# Autodesk Inventor assembly: Zespol_plyty_przedniej
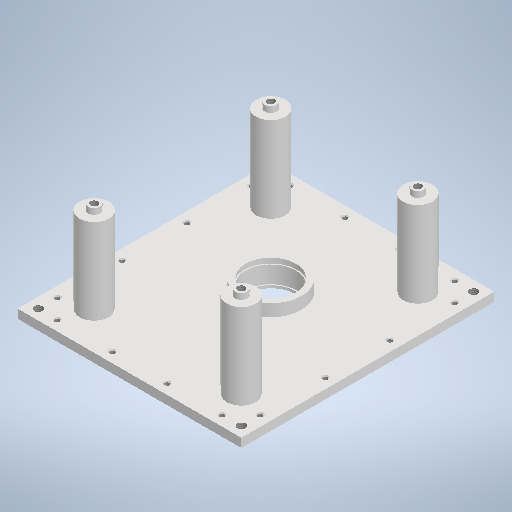
[picture p0: Inventor's stored thumbnail of the model, 512x512]
Saved by Autodesk Inventor 2025.2 (Build 292293000, 293)
## iProperties
Created: 2025-04-30
Part Number: Zespol_plyty_przedniej
Document SubType Name: Assembly
Designer: makst
Author: makst
## Documents named in this file (4)
- C:\Users\makst\OneDrive\Dokumenty\Inventor\ZNL\Zespol_plyty_przedniej.iam
- C:\Users\makst\OneDrive\Dokumenty\Inventor\ZNL\projektkajtka\płyta_przednia.ipt
- C:\Users\makst\OneDrive\Dokumenty\Inventor\ZNL\Tuleja_lożyskowa.ipt
- C:\Users\makst\OneDrive\Dokumenty\Inventor\ZNL\projektkajtka\wspornik.ipt
## Components (6 placed, 3 different names)
1. płyta_przednia:1 — Mate:1, Mate:2, Mate:3, Mate:4, Mate:5, Mate:6, Flush:1, Flush:2, Flush:3, Flush:4
2. Tuleja_lożyskowa:1 — Mate:1, Mate:2
3. wspornik:1 — Mate:6, Flush:1
4. wspornik:2 — Mate:5, Flush:3
5. wspornik:3 — Mate:3, Flush:2
6. wspornik:4 — Mate:4, Flush:4
## Relationships (10: Mate 6, Flush 4)
- Mate:1: płyta_przednia:1 ↔ Tuleja_lożyskowa:1
- Mate:2: płyta_przednia:1 ↔ Tuleja_lożyskowa:1
- Mate:3: płyta_przednia:1 ↔ wspornik:3
- Mate:4: płyta_przednia:1 ↔ wspornik:4
- Mate:5: płyta_przednia:1 ↔ wspornik:2
- Mate:6: płyta_przednia:1 ↔ wspornik:1
- Flush:1: płyta_przednia:1 ↔ wspornik:1
- Flush:2: płyta_przednia:1 ↔ wspornik:3
- Flush:3: płyta_przednia:1 ↔ wspornik:2
- Flush:4: płyta_przednia:1 ↔ wspornik:4
